# Autodesk Inventor assembly: LoweredGlassRing
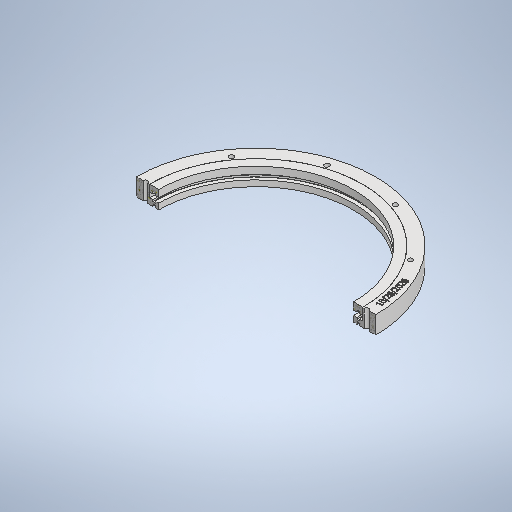
[picture p0: Inventor's stored thumbnail of the model, 512x512]
Saved by Autodesk Inventor 2025 (Build 290162000, 162)
## iProperties
Created: 2026-10-28
Part Number: LoweredGlassRing
Document SubType Name: Assembly
Designer: madhami
Author: madhami
## Documents named in this file (3)
- C:\GitHub\LPBF-Observer\system_development\Damascus\V0.5.1\hardware development\Parts\LoweredGlassRing.iam
- C:\GitHub\LPBF-Observer\system_development\Damascus\V0.5.1\hardware development\Parts\SealedGlassRing_Lowered.ipt
- C:\GitHub\LPBF-Observer\system_development\Damascus\V0.5.1\hardware development\Parts\Adapter_LoweredRing.ipt
## Components (2 placed, 2 different names)
1. SealedGlassRing_Lowered:1 — Insert:1
2. Adapter_LoweredRing:1 — Insert:1
## Relationships (1: Insert 1)
- Insert:1: SealedGlassRing_Lowered:1 ↔ Adapter_LoweredRing:1
